# Autodesk Inventor assembly: Seals_81x93_80
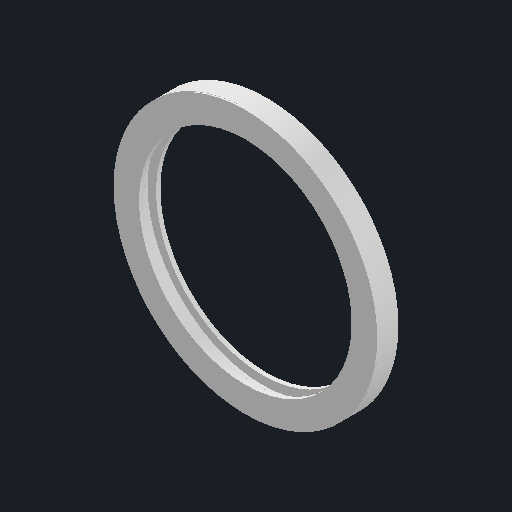
[picture p0: Inventor's stored thumbnail of the model, 512x512]
Saved by Autodesk Inventor 2027.2 (Build 312334000, 334)
## iProperties
Created: 2026-11-16
Part Number: Seals_81x93_80
Document SubType Name: Assembly
Designer: Gasteng5
Author: Gasteng5
## Documents named in this file (3)
- C:\Users\Gasteng5\Documents\ilogic2027\Seals\Outputs\een\Sillicone-Si-blue\Seals_81x93_80.iam
- C:\Users\Gasteng5\Documents\ilogic2027\Seals\Outputs\een\Sillicone-Si-blue\SealIn_81x93_80.ipt
- C:\Users\Gasteng5\Documents\ilogic2027\Seals\Outputs\een\Sillicone-Si-blue\SealOut_81x93_80.ipt
## Components (2 placed, 2 different names)
1. SealOut_81x93_80:1 — Mate:1, Mate:2, Mate:3
2. SealIn_81x93_80:1 — Mate:4, Mate:5, Mate:6
## Relationships (6: Mate 6)
- Mate:1: SealOut_81x93_80:1
- Mate:2: SealOut_81x93_80:1
- Mate:3: SealOut_81x93_80:1
- Mate:4: SealIn_81x93_80:1
- Mate:5: SealIn_81x93_80:1
- Mate:6: SealIn_81x93_80:1
